# Autodesk Inventor assembly: assembly v5
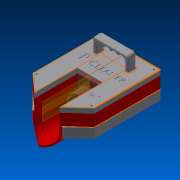
[picture p0: Inventor's stored thumbnail of the model, 180x180]
Saved by Autodesk Inventor 2019 (Build 230136000, 136)
## iProperties
Created: 2019-04-14
Part Number: assembly v5
Document SubType Name: Assembly
Designer: --------
Author: --------
## Documents named in this file (7)
- G:\ASU\Sem8\Design of mecha\Pcleaner V3\PCleanerV3\assembly v5.iam
- G:\ASU\Sem8\Design of mecha\Pcleaner V3\PCleanerV3\chassis v5.ipt
- G:\ASU\Sem8\Design of mecha\Pcleaner V3\PCleanerV3\aquarium pump head.ipt
- G:\ASU\Sem8\Design of mecha\Pcleaner V3\PCleanerV3\base v5.ipt
- G:\ASU\Sem8\Design of mecha\Pcleaner V3\PCleanerV3\Bilge-pump.ipt
- G:\ASU\Sem8\Design of mecha\Pcleaner V3\PCleanerV3\Bilge pump holder v5.ipt
- G:\ASU\Sem8\Design of mecha\Pcleaner V3\PCleanerV3\Foam v5.ipt
## Components (7 placed, 6 different names)
1. aquarium pump head:1 — Mate:4
2. base v5:1 — Mate:4, Flush:1, Flush:2, Mate:5, Mate:10, Flush:3, Flush:4
3. chassis v5:1 — Flush:1, Flush:2, Mate:5
4. Bilge-pump:1 — Mate:6, Mate:7
5. Bilge-pump:2 — Mate:8, Mate:9
6. Bilge pump holder v5:1 — Mate:6, Mate:7, Mate:8, Mate:9, Mate:11, Mate:12, Flush:5
7. Foam v5:1 — Mate:10, Flush:3, Flush:4, Mate:11, Mate:12, Flush:5
## Relationships (14: Mate 9, Flush 5)
- Mate:4: aquarium pump head:1 ↔ base v5:1
- Flush:1: base v5:1 ↔ chassis v5:1
- Flush:2: base v5:1 ↔ chassis v5:1
- Mate:5: base v5:1 ↔ chassis v5:1
- Mate:6: Bilge-pump:1 ↔ Bilge pump holder v5:1
- Mate:7: Bilge-pump:1 ↔ Bilge pump holder v5:1
- Mate:8: Bilge-pump:2 ↔ Bilge pump holder v5:1
- Mate:9: Bilge-pump:2 ↔ Bilge pump holder v5:1
- Mate:10: base v5:1 ↔ Foam v5:1
- Flush:3: base v5:1 ↔ Foam v5:1
- Flush:4: base v5:1 ↔ Foam v5:1
- Mate:11: Bilge pump holder v5:1 ↔ Foam v5:1
- Mate:12 (-50 mm): Bilge pump holder v5:1 ↔ Foam v5:1
- Flush:5 (6.75 mm): Bilge pump holder v5:1 ↔ Foam v5:1
